# Autodesk Inventor assembly: Robot_Autoequilibrado
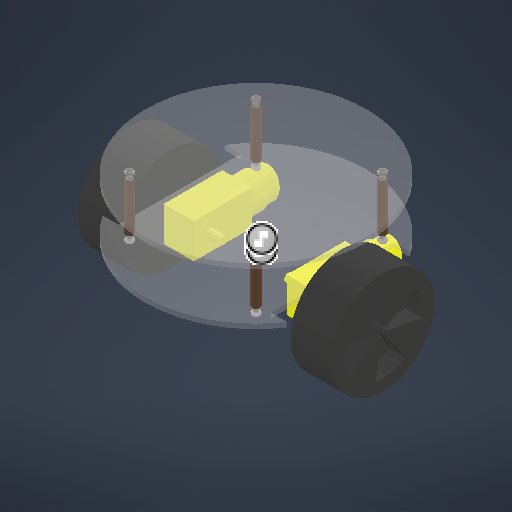
[picture p0: Inventor's stored thumbnail of the model, 512x512]
Saved by Autodesk Inventor 2026.2 (Build 302298010, 298A)
## iProperties
Created: 2026-10-27
Part Number: Robot_Autoequilibrado
Document SubType Name: Assembly
Designer: efrey
Author: efrey
## Documents named in this file (8)
- C:\Users\efrey\OneDrive\Documentos\Inventor\Robot_Autoequilibrado\Robot_Autoequilibrado.iam
- C:\Users\efrey\OneDrive\Documentos\Inventor\Robot_Autoequilibrado\Chasis_Placa_2.ipt
- C:\Users\efrey\OneDrive\Documentos\Inventor\Robot_Autoequilibrado\MOTOR_A.ipt
- C:\Users\efrey\OneDrive\Documentos\Inventor\Robot_Autoequilibrado\MOTOR_B.ipt
- C:\Users\efrey\OneDrive\Documentos\Inventor\Content Center Files\R2026\es-es\Screw GB_T 13806.1-1992 Type A\Screw GB_T 13806.1-1992 A M3 x 4.ipt
- C:\Users\efrey\OneDrive\Documentos\Inventor\Robot_Autoequilibrado\SOPORTES_DOBLE_ROSCADOS.ipt
- C:\Users\efrey\OneDrive\Documentos\Inventor\Robot_Autoequilibrado\Chasis_Placa_1.ipt
- C:\Users\efrey\OneDrive\Documentos\Inventor\Robot_Autoequilibrado\Rueda.ipt
## Components (18 placed, 7 different names)
1. Chasis_Placa_2:1 — Coincidencia:1, Nivelación:1, Coincidencia:2, Coincidencia:3, Nivelación:2, Coincidencia:4, Insertar:1, Insertar:2, Insertar:3, Insertar:4, Coincidencia:6, Coincidencia:8, Coincidencia:10, Coincidencia:12, Coincidencia:19, Coincidencia:20, Nivelación:3, Nivelación:4, Nivelación:5
2. MOTOR_A:1 — Coincidencia:1, Nivelación:1, Coincidencia:2, De rotación:1
3. MOTOR_B:1 — Coincidencia:3, Nivelación:2, Coincidencia:4, De rotación:2
4. Screw GB/T 13806.1-1992 Type A M3 x 4:1 — Insertar:1, Coincidencia:7
5. Screw GB/T 13806.1-1992 Type A M3 x 4:2 — Insertar:2, Coincidencia:5
6. Screw GB/T 13806.1-1992 Type A M3 x 4:3 — Insertar:3, Coincidencia:11
7. Screw GB/T 13806.1-1992 Type A M3 x 4:4 — Insertar:4, Coincidencia:9
8. SOPORTES_DOBLE_ROSCADOS:1 — Coincidencia:5, Coincidencia:6, Coincidencia:16
9. SOPORTES_DOBLE_ROSCADOS:2 — Coincidencia:7, Coincidencia:8, Coincidencia:15, Coincidencia:17
10. SOPORTES_DOBLE_ROSCADOS:3 — Coincidencia:9, Coincidencia:10, Coincidencia:14, Coincidencia:18
11. SOPORTES_DOBLE_ROSCADOS:4 — Coincidencia:11, Coincidencia:12, Coincidencia:13
12. Chasis_Placa_1:1 — Coincidencia:13, Coincidencia:14, Coincidencia:15, Coincidencia:16, Coincidencia:17, Coincidencia:18, Coincidencia:19, Insertar:5, Insertar:6, Insertar:7, Insertar:8
13. Screw GB/T 13806.1-1992 Type A M3 x 4:5 — Insertar:5
14. Screw GB/T 13806.1-1992 Type A M3 x 4:6 — Insertar:6
15. Screw GB/T 13806.1-1992 Type A M3 x 4:7 — Insertar:7
16. Screw GB/T 13806.1-1992 Type A M3 x 4:8 — Insertar:8
17. Rueda:1 — De rotación:1
18. Rueda:2 — De rotación:2
## Relationships (35: Mate 20, Insert 8, Flush 5, RevoluteJoint 2)
- Coincidencia:1 [Mate]: Chasis_Placa_2:1 ↔ MOTOR_A:1
- Nivelación:1 [Flush]: Chasis_Placa_2:1 ↔ MOTOR_A:1
- Coincidencia:2 [Mate] (28.7 mm): Chasis_Placa_2:1 ↔ MOTOR_A:1
- Coincidencia:3 [Mate]: Chasis_Placa_2:1 ↔ MOTOR_B:1
- Nivelación:2 [Flush]: Chasis_Placa_2:1 ↔ MOTOR_B:1
- Coincidencia:4 [Mate] (28.7 mm): Chasis_Placa_2:1 ↔ MOTOR_B:1
- Insertar:1: Chasis_Placa_2:1 ↔ Screw GB/T 13806.1-1992 Type A M3 x 4:1
- Insertar:2: Chasis_Placa_2:1 ↔ Screw GB/T 13806.1-1992 Type A M3 x 4:2
- Insertar:3: Chasis_Placa_2:1 ↔ Screw GB/T 13806.1-1992 Type A M3 x 4:3
- Insertar:4: Chasis_Placa_2:1 ↔ Screw GB/T 13806.1-1992 Type A M3 x 4:4
- Coincidencia:5 [Mate]: Screw GB/T 13806.1-1992 Type A M3 x 4:2 ↔ SOPORTES_DOBLE_ROSCADOS:1
- Coincidencia:6 [Mate]: Chasis_Placa_2:1 ↔ SOPORTES_DOBLE_ROSCADOS:1
- Coincidencia:7 [Mate]: Screw GB/T 13806.1-1992 Type A M3 x 4:1 ↔ SOPORTES_DOBLE_ROSCADOS:2
- Coincidencia:8 [Mate]: Chasis_Placa_2:1 ↔ SOPORTES_DOBLE_ROSCADOS:2
- Coincidencia:9 [Mate]: Screw GB/T 13806.1-1992 Type A M3 x 4:4 ↔ SOPORTES_DOBLE_ROSCADOS:3
- Coincidencia:10 [Mate]: Chasis_Placa_2:1 ↔ SOPORTES_DOBLE_ROSCADOS:3
- Coincidencia:11 [Mate]: Screw GB/T 13806.1-1992 Type A M3 x 4:3 ↔ SOPORTES_DOBLE_ROSCADOS:4
- Coincidencia:12 [Mate]: Chasis_Placa_2:1 ↔ SOPORTES_DOBLE_ROSCADOS:4
- Coincidencia:13 [Mate]: SOPORTES_DOBLE_ROSCADOS:4 ↔ Chasis_Placa_1:1
- Coincidencia:14 [Mate]: SOPORTES_DOBLE_ROSCADOS:3 ↔ Chasis_Placa_1:1
- Coincidencia:15 [Mate]: SOPORTES_DOBLE_ROSCADOS:2 ↔ Chasis_Placa_1:1
- Coincidencia:16 [Mate]: SOPORTES_DOBLE_ROSCADOS:1 ↔ Chasis_Placa_1:1
- Coincidencia:17 [Mate]: SOPORTES_DOBLE_ROSCADOS:2 ↔ Chasis_Placa_1:1
- Coincidencia:18 [Mate]: SOPORTES_DOBLE_ROSCADOS:3 ↔ Chasis_Placa_1:1
- Coincidencia:19 [Mate] (30 mm): Chasis_Placa_2:1 ↔ Chasis_Placa_1:1
- Insertar:5: Chasis_Placa_1:1 ↔ Screw GB/T 13806.1-1992 Type A M3 x 4:5
- Insertar:6: Chasis_Placa_1:1 ↔ Screw GB/T 13806.1-1992 Type A M3 x 4:6
- Insertar:7: Chasis_Placa_1:1 ↔ Screw GB/T 13806.1-1992 Type A M3 x 4:7
- Insertar:8: Chasis_Placa_1:1 ↔ Screw GB/T 13806.1-1992 Type A M3 x 4:8
- De rotación:1 [RevoluteJoint] (-28 mm): MOTOR_A:1 ↔ Rueda:1
- De rotación:2 [RevoluteJoint] (-28 mm): MOTOR_B:1 ↔ Rueda:2
- Coincidencia:20 [Mate]: Chasis_Placa_2:1
- Nivelación:3 [Flush]: Chasis_Placa_2:1
- Nivelación:4 [Flush]: Chasis_Placa_2:1
- Nivelación:5 [Flush]: Chasis_Placa_2:1
